# Autodesk Inventor assembly: MM0948AN140_G00_802
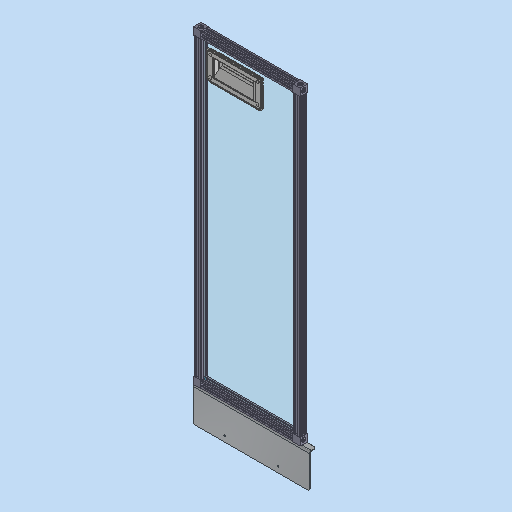
[picture p0: Inventor's stored thumbnail of the model, 512x512]
Saved by Autodesk Inventor 2023.3 (Build 273359000, 359)
## iProperties
Created: 2023-03-23
Part Number: MM0948AN140_G00_802
Description: =<RBPARTNOTITLE2>
Document SubType Name: Assembly
Designer: FH/Wi
Mass: 1929.07 g
Surface Area: 9158.47 cm^2
Volume: 1060.12 cm^3
Density: 1.81967 g/cm^3
AnP_Kategorie: 98
AnP_Material: =<Material>
AnP_TemplVers: 20200821
RBDOCUMENTTYPE: DRF
RBDOCUMENTVERSION: 00
RBDRAWINGMAINSCALE: 1:1
RBDRAWINGMISSINGSPEC: --
RBDRAWINGVOLUME: --
RBDSV1: 0850
RBGBEDGESIN1: +0,5
RBGBEDGESIN2: +0,2
RBGBEDGESOUT1: -0,3
RBGBEDGESOUT2: -0,1
RBMATERIAL: =<Material>
RBMATMEETS: --
RBMATNO: =<Part Number>
RBPARTMADEOF: --
RBPARTNO: SIEHE MNR
RBPARTNOTITLE1: enter description here
RBPARTNOTITLE2: hier Bezeichnung eintragen
RBPARTSAFETYINDICATOR: --
RBSURFACE: --
RBSURFACE2: --
RBZEDGESNORM: ISO13715:2002-06
RBZGENDIMCLASS: m
RBZGENDIMNORM: ISO 2768-1:1989-11
RBZGENGEOCLASS: H
RBZGENGEONORM: ISO 2768-2:1989-11
RBZSURFACENORM: ISO13D2:2002-02
RBZTOLERANCENORM: ISO 14405-1:2010-12
Author: FH/Wi
Keywords: =<RBPARTMADEOF>
Comments: =<RBSURFACE2>
Revision Number: 01
## Documents named in this file (8)
- C:\Users\rea9an\Documents\Inventor\TCAI2412_te1910_EM\AS00000952.iam
- C:\Users\rea9an\Documents\Inventor\TCAI2412_te1910_EM\PT00004321.ipt
- C:\Users\rea9an\Documents\Inventor\TCAI2412_te1910_EM\PT00004405.ipt
- C:\Users\rea9an\Documents\Inventor\TCAI2412_te1910_EM\PT00004669.ipt
- C:\Users\rea9an\Documents\Inventor\TCAI2412_te1910_EM\PT00004668.ipt
- C:\Users\rea9an\Documents\Inventor\TCAI2412_te1910_EM\PT00004823.ipt
- C:\Users\rea9an\Documents\Inventor\TCAI2412_te1910_EM\PT00004341.ipt
- C:\Users\rea9an\Documents\Inventor\TCAI2412_te1910_EM\PT00004344.ipt
## Components (15 placed, 7 different names)
1. PT00004668:1 — Passend:25, Passend:29
2. PT00004669:1 — Fluchtend:6, Passend:27, Fluchtend:8
3. PT00004823:4
4. PT00004823:3
5. PT00004823:1
6. PT00004823:2
7. PT00004344:2
8. PT00004344:1
9. PT00004341:1 — Passend:29
10. PT00004341:2 — Fluchtend:7, Passend:25
11. PT00004321:1
12. PT00004321:2 — Fluchtend:7
13. PT00004321:3
14. PT00004321:4 — Fluchtend:6, Passend:27, Fluchtend:8
15. PT00004405:1
## Relationships (30: Mate 21, Flush 5, Insert 4)
- [Mate]: PT00004344:2 ↔ PT00004321:1
- [Mate]: PT00004344:1 ↔ PT00004321:2
- [Mate]: PT00004344:2 ↔ PT00004321:3
- [Mate]: PT00004344:1 ↔ PT00004321:4
- [Mate]: PT00004344:2 ↔ PT00004321:3
- [Mate]: PT00004344:1 ↔ PT00004321:4
- [Mate]: PT00004341:1 ↔ PT00004321:3
- [Mate]: PT00004341:1 ↔ PT00004321:4
- [Mate]: PT00004341:2 ↔ PT00004321:2
- [Mate]: PT00004341:2 ↔ PT00004321:1
- [Mate]: PT00004668:1 ↔ PT00004405:1
- [Mate]: PT00004668:1 ↔ PT00004405:1
- [Mate]: PT00004668:1 ↔ PT00004405:1
- [Insert]: PT00004668:1 ↔ PT00004823:1
- [Insert]: PT00004668:1 ↔ PT00004823:4
- [Insert]: PT00004668:1 ↔ PT00004823:2
- [Insert]: PT00004668:1 ↔ PT00004823:3
- [Flush]: PT00004344:2 ↔ PT00004321:3
- [Flush]: PT00004344:2 ↔ PT00004321:1
- [Mate]: PT00004341:1 ↔ PT00004321:3
- [Mate]: PT00004341:2 ↔ PT00004321:1
- Passend:25 [Mate] (1.5 mm): PT00004668:1 ↔ PT00004341:2
- [Mate]: PT00004341:1 ↔ PT00004321:4
- Fluchtend:6 [Flush]: PT00004669:1 ↔ PT00004321:4
- Passend:27 [Mate]: PT00004669:1 ↔ PT00004321:4
- Fluchtend:7 [Flush]: PT00004341:2 ↔ PT00004321:2
- [Mate]: PT00004344:1 ↔ PT00004321:2
- Fluchtend:8 [Flush]: PT00004669:1 ↔ PT00004321:4
- Passend:29 [Mate] (1.5 mm): PT00004668:1 ↔ PT00004341:1
- [Mate] (1.5 mm): PT00004668:1 ↔ PT00004344:2
